# Autodesk Inventor assembly: motorShaft Assembly
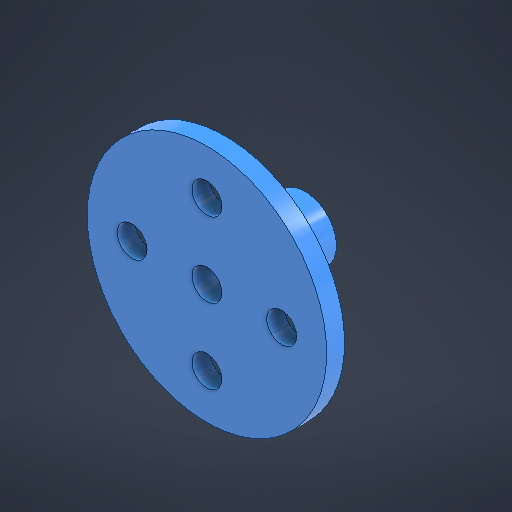
[picture p0: Inventor's stored thumbnail of the model, 512x512]
Saved by Autodesk Inventor 2027.1 (Build 311270010, 270A)
## iProperties
Created: 2026-10-13
Part Number: motorShaft Assembly
Document SubType Name: Assembly
Designer: User
Author: User
## Documents named in this file (8)
- C:\Users\Ahmed\Desktop\Fall 26\Design 1 Repo\MCT333_Design_of_Mechatronics_Systems_1\CAD\FEED and Sorting\motorShaft Assembly.iam
- C:\Users\Ahmed\Desktop\Fall 26\Design 1 Repo\MCT333_Design_of_Mechatronics_Systems_1\CAD\FEED and Sorting\Part25.ipt
- C:\Users\Ahmed\Desktop\Fall 26\Design 1 Repo\MCT333_Design_of_Mechatronics_Systems_1\CAD\FEED and Sorting\motorShaft Assembly\AIP\FEA\fm4kqgtog.fins
- C:\Users\Ahmed\Desktop\Fall 26\Design 1 Repo\MCT333_Design_of_Mechatronics_Systems_1\CAD\FEED and Sorting\motorShaft Assembly\AIP\FEA\fm4kqgtog.fsat
- C:\Users\Ahmed\Desktop\Fall 26\Design 1 Repo\MCT333_Design_of_Mechatronics_Systems_1\CAD\FEED and Sorting\motorShaft Assembly\AIP\FEA\fm4kqgtog.ftes
- C:\Users\Ahmed\Desktop\Fall 26\Design 1 Repo\MCT333_Design_of_Mechatronics_Systems_1\CAD\FEED and Sorting\motorShaft Assembly\AIP\FEA\fm4kqgtog.fwiz
- C:\Users\Ahmed\Desktop\Fall 26\Design 1 Repo\MCT333_Design_of_Mechatronics_Systems_1\CAD\FEED and Sorting\motorShaft Assembly\AIP\FEA\fm4kqgtoh.fmsh
- C:\Users\Ahmed\Desktop\Fall 26\Design 1 Repo\MCT333_Design_of_Mechatronics_Systems_1\CAD\FEED and Sorting\motorShaft Assembly\AIP\FEA\fm4l6swtc.fres
## Components (1 placed, 1 different names)
1. Part25:1 — Mate:1, Mate:2
## Relationships (3: Mate 3)
- Mate:1: Part25:1
- Mate:2: Part25:1
- Mate:3
## Named parameters: sa_0 = 0, sa_1 = 3100, sa_2 = 0, sa_6 = 0, sa_7 = -3100, sa_8 = 0
note: some values were not read from the file. Shown as the stored number, unit unknown: "sa_0", "sa_1", "sa_2", "sa_6", "sa_7", "sa_8".
